# Autodesk Inventor assembly: Ensamble acople_porta
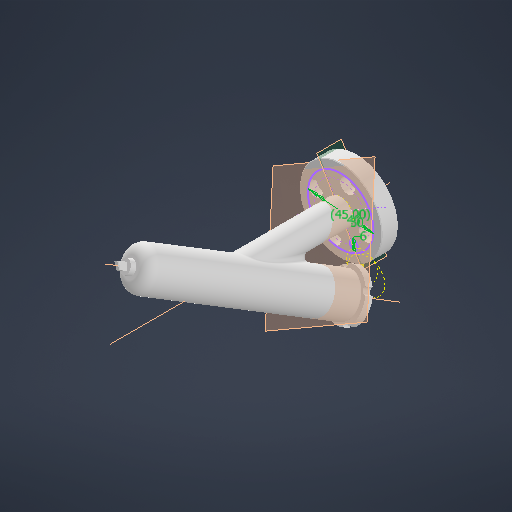
[picture p0: Inventor's stored thumbnail of the model, 512x512]
Saved by Autodesk Inventor 2027.1 (Build 311270010, 270A)
## iProperties
Created: 2026-09-24
Part Number: Ensamble acople_porta
Document SubType Name: Assembly
Designer: Alexandra Garavito
Author: Alexandra Garavito
## Documents named in this file (4)
- C:\Users\felip\Desktop\Ensamble acople_porta.iam
- C:\Users\felip\Desktop\porta_marcador.ipt
- C:\Users\felip\Desktop\Acople porta-brida.ipt
- C:\Users\felip\Desktop\Tapa.ipt
## Components (3 placed, 3 different names)
1. porta_marcador:1 — De rotación:1, De rotación:2, Nivelación:2, Coincidencia:2, Coincidencia:4, Coincidencia:6
2. Acople porta-brida:1 — De rotación:1, Nivelación:1, Nivelación:3, Coincidencia:2, Nivelación:4, Coincidencia:6
3. Tapa:1 — De rotación:2
## Relationships (12: Mate 6, Flush 4, RevoluteJoint 2)
- De rotación:1 [RevoluteJoint]: porta_marcador:1 ↔ Acople porta-brida:1
- De rotación:2 [RevoluteJoint]: porta_marcador:1 ↔ Tapa:1
- Nivelación:1 [Flush]: Acople porta-brida:1
- Nivelación:2 [Flush]: porta_marcador:1
- Nivelación:3 [Flush]: Acople porta-brida:1
- Coincidencia:1 [Mate]
- Coincidencia:2 [Mate]: porta_marcador:1 ↔ Acople porta-brida:1
- Nivelación:4 [Flush]: Acople porta-brida:1
- Coincidencia:3 [Mate]
- Coincidencia:4 [Mate]: porta_marcador:1
- Coincidencia:5 [Mate]
- Coincidencia:6 [Mate]: porta_marcador:1 ↔ Acople porta-brida:1
